# Autodesk Inventor assembly: End Effector
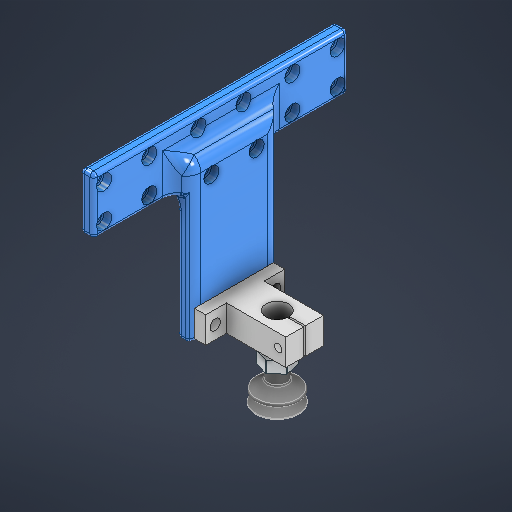
[picture p0: Inventor's stored thumbnail of the model, 512x512]
Saved by Autodesk Inventor 2027.1 (Build 311270010, 270A)
## iProperties
Created: 2026-10-12
Part Number: End Effector
Document SubType Name: Assembly
Designer: Ahmed
Author: Ahmed
## iProperties of the stored document Suction-ohne-nippel.ipt
Created: 2014-03-17
Part Number: Suction-ohne-nippel
Material: Generic
Document SubType Name: Modeling
Designer: Ahmed
Density: 1 g/cm^3
Appearance: Default
Sending System: SOLIDWORKS 2012
Last Saved Date: 2014-05-13
last saved by: Oleg
Author: Ahmed
## iProperties of the stored document nippel.ipt
Created: 2014-03-17
Part Number: nippel
Material: Generic
Document SubType Name: Modeling
Designer: Ahmed
Density: 1 g/cm^3
Appearance: Default
Sending System: SOLIDWORKS 2012
Last Saved Date: 2014-05-13
last saved by: Oleg
Author: Ahmed
## iProperties of the stored document Suction.iam
Created: 2014-03-17
Part Number: Suction
Document SubType Name: Assembly
Designer: Ahmed
Sending System: SOLIDWORKS 2012
last saved by: Oleg
Last Saved Date: 2014-05-13
Author: Ahmed
## Documents named in this file (9)
- **C:\Users\Ahmed\Desktop\Fall 26\MCT333 Design of Mechatronics Systems 1\Project\CAD\End Effector.iam*LocalDocs*xAaaaqocaAaaaaaaaAaaaahhiZd*Suction-ohne-nippel.ipt
- **C:\Users\Ahmed\Desktop\Fall 26\MCT333 Design of Mechatronics Systems 1\Project\CAD\End Effector.iam*LocalDocs*xAaaaqcaaAaaaaaaaAaaaartaOc*nippel.ipt
- **C:\Users\Ahmed\Desktop\Fall 26\MCT333 Design of Mechatronics Systems 1\Project\CAD\End Effector.iam*LocalDocs*xAaaaqrcaAaaaaaaaAaaaavx3Dc*Suction.iam
- C:\Users\Ahmed\Desktop\Fall 26\MCT333 Design of Mechatronics Systems 1\Project\CAD\End Effector.iam
- C:\Users\Ahmed\Desktop\Fall 26\MCT333 Design of Mechatronics Systems 1\Project\CAD\Suction Cup Fixation.ipt
- C:\Users\Ahmed\Desktop\Fall 26\MCT333 Design of Mechatronics Systems 1\Project\CAD\SK12 SHAFT HOLDER\SK12 SHAFT HOLDER.ipt
- C:\Users\Ahmed\Desktop\Fall 26\MCT333 Design of Mechatronics Systems 1\Project\CAD\Suction.SLDASM
- C:\Users\Ahmed\Desktop\Fall 26\MCT333 Design of Mechatronics Systems 1\Project\CAD\nippel.SLDPRT
- C:\Users\Ahmed\Desktop\Fall 26\MCT333 Design of Mechatronics Systems 1\Project\CAD\Suction-ohne-nippel.SLDPRT
## Components (3 placed, 3 different names)
1. Suction Cup Fixation:1 — Mate:4, Mate:5, Mate:6
2. SK12 SHAFT HOLDER:1 — Mate:2, Mate:3, Mate:4, Mate:5, Mate:6
3. Suction:1 [sub-assembly] — Mate:2, Mate:3
## Relationships (5: Mate 5)
- Mate:2: SK12 SHAFT HOLDER:1 ↔ Suction:1
- Mate:3 (4 mm): SK12 SHAFT HOLDER:1 ↔ Suction:1
- Mate:4: Suction Cup Fixation:1 ↔ SK12 SHAFT HOLDER:1
- Mate:5: Suction Cup Fixation:1 ↔ SK12 SHAFT HOLDER:1
- Mate:6: Suction Cup Fixation:1 ↔ SK12 SHAFT HOLDER:1
